# Autodesk Inventor assembly: MM0948AN130_G13_500
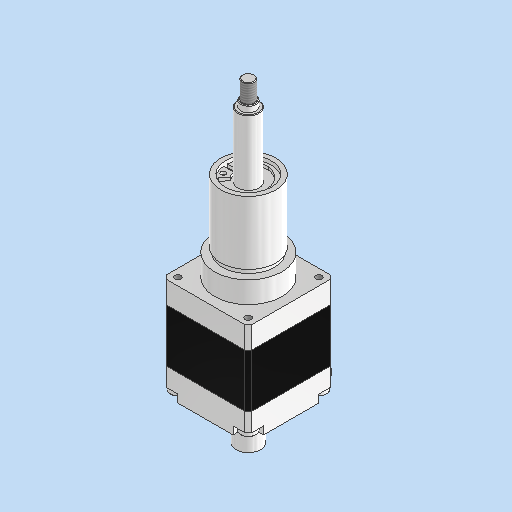
[picture p0: Inventor's stored thumbnail of the model, 512x512]
Saved by Autodesk Inventor 2023.3 (Build 273359000, 359)
## iProperties
Created: 2024-11-11
Part Number: MM0948AN130_G13_500
Description: =<RBPARTNOTITLE2>
Vendor: Nanotec
Document SubType Name: Assembly
Designer: RIC7AN
Mass: 150 g
Surface Area: 126.915 cm^2
Volume: 34.918 cm^3
Density: 4.29577 g/cm^3
RBPARTMADEOF: LGA281S10-B-UGFC-019
RBDRAWINGMISSINGSPEC: --
AnP_Kategorie: 11
RBPARTNOTITLE2: Linearaktuator
RBGBREMARKSINDEX: E
RBSURFACE: --
RBPARTNOTITLE1: linear acuator
AnP_Material: =<Material>
RBMATERIAL: =<Material>
RBMATNO: =<Part Number>
RBPARTNO: SIEHE MNR
Author: RIC7AN
Keywords: =<RBPARTMADEOF>
Comments: =<RBSURFACE2>
Revision Number: 01
## Documents named in this file (3)
- C:\Users\rea9an\Documents\Inventor\TCAI2412_te1910_EM\AS00000950.iam
- C:\Users\rea9an\Documents\Inventor\TCAI2412_te1910_EM\PT00004659.ipt
- C:\Users\rea9an\Documents\Inventor\TCAI2412_te1910_EM\PT00004660.ipt
## Components (2 placed, 2 different names)
1. PT00004659:1 — Fluchtend:1, Fluchtend:2, Fluchtend:3, Passend:1, Fluchtend:4, Fluchtend:5, Fluchtend:6
2. PT00004660:1 — Passend:1, Fluchtend:4, Fluchtend:5, Fluchtend:6
## Relationships (7: Flush 6, Mate 1)
- Fluchtend:1 [Flush]: PT00004659:1
- Fluchtend:2 [Flush]: PT00004659:1
- Fluchtend:3 [Flush]: PT00004659:1
- Passend:1 [Mate]: PT00004659:1 ↔ PT00004660:1
- Fluchtend:4 [Flush] (-8 mm): PT00004659:1 ↔ PT00004660:1
- Fluchtend:5 [Flush] (-8 mm): PT00004659:1 ↔ PT00004660:1
- Fluchtend:6 [Flush] (-27.1 mm): PT00004659:1 ↔ PT00004660:1
